# Autodesk Inventor assembly: 5v 18mm
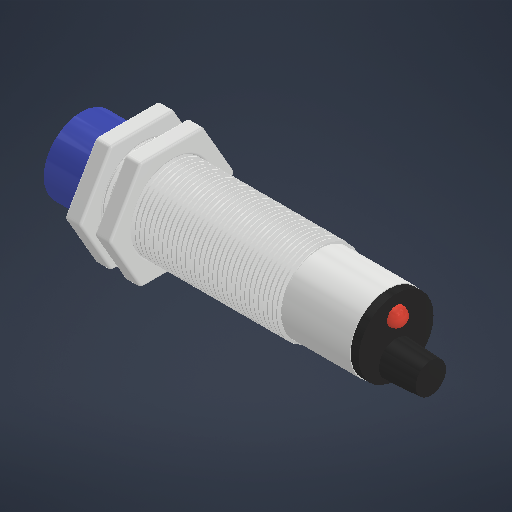
[picture p0: Inventor's stored thumbnail of the model, 512x512]
Saved by Autodesk Inventor 2027.1 (Build 311270010, 270A)
## iProperties
Created: 2020-10-23
Part Number: 5v 18mm
Document SubType Name: Assembly
Designer: daniel
Sending System: Autodesk Translation Framework v9.3.0.1241
Preprocessor: ST-DEVELOPER v18.1
Title: C:/Users/tempi/Documents/3D Printing/Inductive Proximity Sensor Assembly.step
## Documents named in this file (3)
- E:\Apps\AutodeskInventor\University\MCT333_Design_of_Mechatronics_Systems_1\CAD\electronic_components\18mm-inductive-proximity-sensor-taiss-4\Inductive Proximity Sensor Assembly\Inductive Proximity Sensor Assembly.iam
- E:\Apps\AutodeskInventor\University\MCT333_Design_of_Mechatronics_Systems_1\CAD\electronic_components\18mm-inductive-proximity-sensor-taiss-4\Inductive Proximity Sensor Assembly\Sensor.ipt
- E:\Apps\AutodeskInventor\University\MCT333_Design_of_Mechatronics_Systems_1\CAD\electronic_components\18mm-inductive-proximity-sensor-taiss-4\Inductive Proximity Sensor Assembly\Nut.ipt
## Components (3 placed, 2 different names)
1. Sensor:1 — Mate:7, Flush:1
2. Nut:1 — Mate:4, Flush:1, Mate:8
3. Nut:2 — Mate:4, Mate:7, Mate:8
## Relationships (4: Mate 3, Flush 1)
- Mate:4: Nut:1 ↔ Nut:2
- Mate:7: Sensor:1 ↔ Nut:2
- Flush:1 (10 mm): Sensor:1 ↔ Nut:1
- Mate:8 (3 mm): Nut:1 ↔ Nut:2
